# Autodesk Inventor assembly: MM0861AN105_G11_503
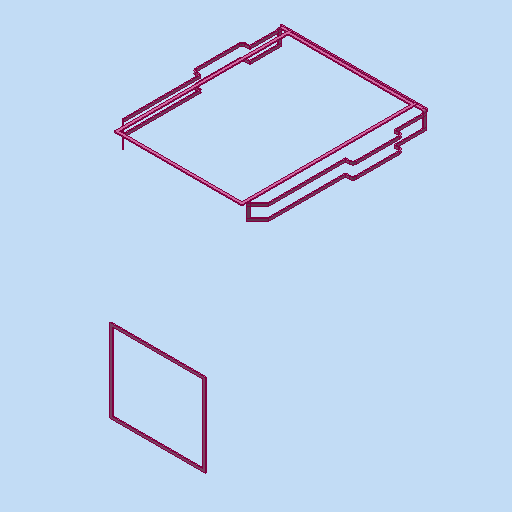
[picture p0: Inventor's stored thumbnail of the model, 512x512]
Saved by Autodesk Inventor 2023.3 (Build 273359000, 359)
## iProperties
RuleStatus: InUse
BeforeDocSave0: file://AnP_Ansicht_ausrichten
Part Number: MM0861AN105_G11_503
Material: Generisch
Description: =<RBPARTNOTITLE2>
Vendor: Häwa
Document SubType Name: Assembly
Designer: ric7an
Mass: 346.619 g
Surface Area: 2338.41 cm^2
Volume: 346.619 cm^3
Density: 1 g/cm^3
RBCHANGEDESCRIPTION1: Erstfreigabe
RBCHANGENO1: 00
RBDOCUMENTTYPE: DRF
RBDOCUMENTVERSION: 00
RBDRAWINGMAINSCALE: 1:1
RBDRAWINGMISSINGSPEC: --
RBDRAWINGVOLUME: --
RBDSV1: 0850
RBGBDETAILS: 43274
RBGBEDGESIN1: +0,5
RBGBEDGESIN2: +0,2
RBGBEDGESOUT1: -0,3
RBGBEDGESOUT2: -0,1
RBMATERIAL: --
RBMATMEETS: --
RBMATNO: =<Part Number>
RBORGUNITRESPONSIBLE1: AnP/TEF1
RBPARTMADEOF: 3080-0102-18-00/ 5,5 m
RBPARTNO: SIEHE MNR
RBPARTNOTITLE1: gasket
RBPARTNOTITLE2: Dichtungsgummi selbstklebend
RBPARTSAFETYINDICATOR: --
RBSURFACE: --
RBSURFACE2: --
RBZEDGESNORM: ISO13715:2002-06
RBZGENDIMCLASS: m
RBZGENDIMNORM: ISO 2768-1:1989-11
RBZGENGEOCLASS: H
RBZGENGEONORM: ISO 2768-2:1989-11
RBZSURFACENORM: ISO13D2:2002-02
RBZTOLERANCENORM: ISO 14405-1:2010-12
AnP_Kommentar: --
MaxAbmaße: --
AnP_TemplVers: 20190222
AnP_Kategorie: 2
AnP_Material: =<Material>
Author: ric7an
Keywords: =<RBPARTMADEOF>
Comments: =<RBSURFACE2>
Revision Number: 01
## Documents named in this file (7)
- C:\Users\rea9an\Documents\Inventor\TCAI2412_te1910_EM\AS00000893.iam
- C:\Users\rea9an\Documents\Inventor\TCAI2412_te1910_EM\PT00004440.ipt
- C:\Users\rea9an\Documents\Inventor\TCAI2412_te1910_EM\PT00004439.ipt
- C:\Users\rea9an\Documents\Inventor\TCAI2412_te1910_EM\PT00004441.ipt
- C:\Users\rea9an\Documents\Inventor\TCAI2412_te1910_EM\PT00004442.ipt
- C:\Users\rea9an\Documents\Inventor\TCAI2412_te1910_EM\PT00004443.ipt
- C:\Users\rea9an\Documents\Inventor\TCAI2412_te1910_EM\PT00004444.ipt
## Components (11 placed, 6 different names)
1. PT00004440:1
2. PT00004440:2
3. PT00004439:1
4. PT00004441:1
5. PT00004442:1
6. PT00004442:2
7. PT00004443:1
8. PT00004443:2
9. PT00004444:1 — Fluchtend:3, Fluchtend:4, Passend:3
10. PT00004440:3
11. PT00004440:4
## Relationships (9: Flush 5, Mate 4)
- [Mate]: PT00004440:1 ↔ PT00004442:2
- [Flush]: PT00004440:1 ↔ PT00004442:2
- [Flush]: PT00004440:2 ↔ PT00004442:1
- [Mate]: PT00004440:2 ↔ PT00004442:1
- Fluchtend:3 [Flush] (-1138 mm): PT00004444:1
- Fluchtend:4 [Flush] (4 mm): PT00004444:1
- Passend:3 [Mate] (297 mm): PT00004444:1
- [Flush]: PT00004440:3 ↔ PT00004440:4
- [Mate] (42 mm): PT00004440:2 ↔ PT00004440:3
